# Autodesk Inventor assembly: 测试架
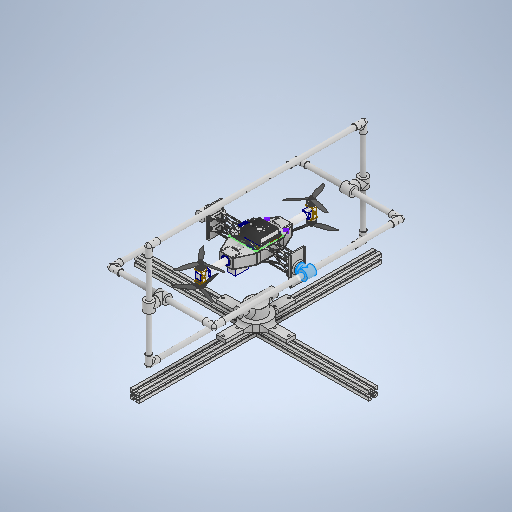
[picture p0: Inventor's stored thumbnail of the model, 512x512]
Saved by Autodesk Inventor 2025 (Build 290162000, 162)
## iProperties
Created: 2026-11-18
Part Number: 测试架
Document SubType Name: Assembly
Designer: ylh00
Mass: 7261.8 g
Surface Area: 21946.2 cm^2
Volume: 4232.95 cm^3
Density: 1.71554 g/cm^3
Author: ylh00
## Documents named in this file (20)
- D:\双轴共轴\测试台\测试架.iam
- D:\双轴共轴\测试台\安装架1.ipt
- D:\双轴共轴\测试台\76碳管.ipt
- D:\双轴共轴\测试台\40碳管.ipt
- D:\双轴共轴\测试台\外轴承支架.ipt
- D:\双轴共轴\测试台\轴承.ipt
- D:\双轴共轴\测试台\轴1.ipt
- D:\双轴共轴\测试台\内轴承支架.ipt
- D:\双轴共轴\测试台\88碳管.ipt
- D:\双轴共轴\测试台\底部固定.ipt
- D:\双轴共轴\测试台\轴2.ipt
- D:\双轴共轴\测试台\底部固定1.ipt
- D:\双轴共轴\测试台\4040_1000mm.ipt
- D:\双轴共轴\测试台\4040_500mm.ipt
- D:\双轴共轴\测试台\内轴承支架1.ipt
- D:\双轴共轴\测试台\六面螺母.ipt
- D:\双轴共轴\测试台\安装支架.ipt
- D:\双轴共轴\测试台\安装支架_MIR.ipt
- D:\双轴共轴\测试台\六面螺母_MIR.ipt
- D:\双轴共轴\测试台\飞机\飞机.ipt
## Components (51 placed, 19 different names)
1. 安装架1:1 — 刚性:1, 刚性:2
2. 安装架1:2 — 刚性:5
3. 安装架1:3 — 刚性:6, 刚性:7
4. 安装架1:4 — 刚性:3, 刚性:4
5. 76碳管:1 — 刚性:1, 刚性:6, 刚性:10
6. 76碳管:2 — 刚性:4, 刚性:5, 刚性:11
7. 40碳管:1 — 刚性:2, 刚性:3, 刚性:9
8. 40碳管:2 — 刚性:7, 刚性:8
9. 外轴承支架:1 — 刚性:8, 旋转:4
10. 外轴承支架:2 — 刚性:9, 旋转:3
11. 外轴承支架:3 — 刚性:10, 旋转:1
12. 外轴承支架:4 — 刚性:11, 旋转:2
13. 轴承:1 — 旋转:1, 旋转:8
14. 轴承:2 — 旋转:2, 旋转:7
15. 轴承:3 — 旋转:4, 旋转:5
16. 轴承:4 — 旋转:3, 旋转:6
17. 轴1:1 — 旋转:7, 旋转:19
18. 轴1:2 — 旋转:8, 旋转:18
19. 轴1:3 — 旋转:6, 旋转:9
20. 轴1:4 — 旋转:5, 旋转:10
21. 内轴承支架:1 — 旋转:9, 刚性:13
22. 内轴承支架:2 — 旋转:10, 刚性:12
23. 40碳管:3 — 刚性:12, 旋转:12, 旋转:13
24. 40碳管:4 — 刚性:13, 旋转:11, 旋转:15
25. 安装架1:5 — 旋转:13, 旋转:14
26. 安装架1:6 — 旋转:11
27. 安装架1:7 — 旋转:15
28. 安装架1:8 — 旋转:12, 刚性:14
29. 88碳管:1 — 刚性:14
30. 88碳管:2 — 旋转:14, 刚性:15
31. 底部固定:1 — 刚性:15, 旋转:16
32. 轴2:1 — 旋转:16, 旋转:17
33. 底部固定1:1 — 旋转:17, 刚性:16
34. 4040_1000mm:1 — 刚性:16, 刚性:17, 刚性:18
35. 4040_500mm:1 — 刚性:17
36. 4040_500mm:2 — 刚性:18
37. 内轴承支架1:1 — 旋转:18, 滑块:1, 滑块:2, 对称:1, 对称:2
38. 内轴承支架1:2 — 旋转:19, 滑块:3, 滑块:4, 对称:1, 对称:2
39. 六面螺母:1 — 滑块:1
40. 六面螺母:2 — 滑块:3, 旋转:21
41. 六面螺母:3 — 滑块:4, 旋转:20
42. 六面螺母:4 — 滑块:2
43. 安装支架:3 — 旋转:21
44. 安装支架:4 — 旋转:20
45. 安装支架_MIR:1
46. 安装支架_MIR:2 — 旋转:22
47. 六面螺母_MIR:1
48. 六面螺母_MIR:2
49. 六面螺母_MIR:3
50. 六面螺母_MIR:4
51. 飞机:1 — 旋转:22
## Relationships (46: RevoluteJoint 22, WeldJoint 18, TranslationJoint 4, Symmetry 2)
- 刚性:1 [WeldJoint]: 安装架1:1 ↔ 76碳管:1
- 刚性:2 [WeldJoint]: 安装架1:1 ↔ 40碳管:1
- 刚性:3 [WeldJoint]: 安装架1:4 ↔ 40碳管:1
- 刚性:4 [WeldJoint]: 安装架1:4 ↔ 76碳管:2
- 刚性:5 [WeldJoint]: 安装架1:2 ↔ 76碳管:2
- 刚性:6 [WeldJoint]: 安装架1:3 ↔ 76碳管:1
- 刚性:7 [WeldJoint]: 安装架1:3 ↔ 40碳管:2
- 刚性:8 [WeldJoint]: 40碳管:2 ↔ 外轴承支架:1
- 刚性:9 [WeldJoint]: 40碳管:1 ↔ 外轴承支架:2
- 刚性:10 [WeldJoint]: 76碳管:1 ↔ 外轴承支架:3
- 刚性:11 [WeldJoint]: 76碳管:2 ↔ 外轴承支架:4
- 旋转:1 [RevoluteJoint]: 外轴承支架:3 ↔ 轴承:1
- 旋转:2 [RevoluteJoint]: 外轴承支架:4 ↔ 轴承:2
- 旋转:3 [RevoluteJoint]: 外轴承支架:2 ↔ 轴承:4
- 旋转:4 [RevoluteJoint]: 外轴承支架:1 ↔ 轴承:3
- 旋转:5 [RevoluteJoint]: 轴承:3 ↔ 轴1:4
- 旋转:6 [RevoluteJoint]: 轴承:4 ↔ 轴1:3
- 旋转:7 [RevoluteJoint]: 轴承:2 ↔ 轴1:1
- 旋转:8 [RevoluteJoint]: 轴承:1 ↔ 轴1:2
- 旋转:9 [RevoluteJoint]: 轴1:3 ↔ 内轴承支架:1
- 旋转:10 [RevoluteJoint]: 轴1:4 ↔ 内轴承支架:2
- 刚性:12 [WeldJoint]: 内轴承支架:2 ↔ 40碳管:3
- 刚性:13 [WeldJoint]: 内轴承支架:1 ↔ 40碳管:4
- 旋转:11 [RevoluteJoint]: 40碳管:4 ↔ 安装架1:6
- 旋转:12 [RevoluteJoint]: 40碳管:3 ↔ 安装架1:8
- 刚性:14 [WeldJoint]: 安装架1:8 ↔ 88碳管:1
- 旋转:13 [RevoluteJoint]: 40碳管:3 ↔ 安装架1:5
- 旋转:14 [RevoluteJoint]: 安装架1:5 ↔ 88碳管:2
- 旋转:15 [RevoluteJoint]: 40碳管:4 ↔ 安装架1:7
- 刚性:15 [WeldJoint]: 88碳管:2 ↔ 底部固定:1
- 旋转:16 [RevoluteJoint]: 底部固定:1 ↔ 轴2:1
- 旋转:17 [RevoluteJoint]: 轴2:1 ↔ 底部固定1:1
- 刚性:16 [WeldJoint] (11 mm): 底部固定1:1 ↔ 4040_1000mm:1
- 刚性:17 [WeldJoint] (11 mm): 4040_1000mm:1 ↔ 4040_500mm:1
- 刚性:18 [WeldJoint] (-11 mm): 4040_1000mm:1 ↔ 4040_500mm:2
- 旋转:18 [RevoluteJoint]: 轴1:2 ↔ 内轴承支架1:1
- 旋转:19 [RevoluteJoint]: 轴1:1 ↔ 内轴承支架1:2
- 滑块:1 [TranslationJoint]: 内轴承支架1:1 ↔ 六面螺母:1
- 滑块:2 [TranslationJoint]: 内轴承支架1:1 ↔ 六面螺母:4
- 滑块:3 [TranslationJoint]: 内轴承支架1:2 ↔ 六面螺母:2
- 滑块:4 [TranslationJoint]: 内轴承支架1:2 ↔ 六面螺母:3
- 旋转:20 [RevoluteJoint]: 六面螺母:3 ↔ 安装支架:4
- 旋转:21 [RevoluteJoint]: 六面螺母:2 ↔ 安装支架:3
- 对称:1 [Symmetry]: 内轴承支架1:1 ↔ 内轴承支架1:2
- 对称:2 [Symmetry]: 内轴承支架1:1 ↔ 内轴承支架1:2
- 旋转:22 [RevoluteJoint]: 安装支架_MIR:2 ↔ 飞机:1
